# Autodesk Inventor assembly: holder
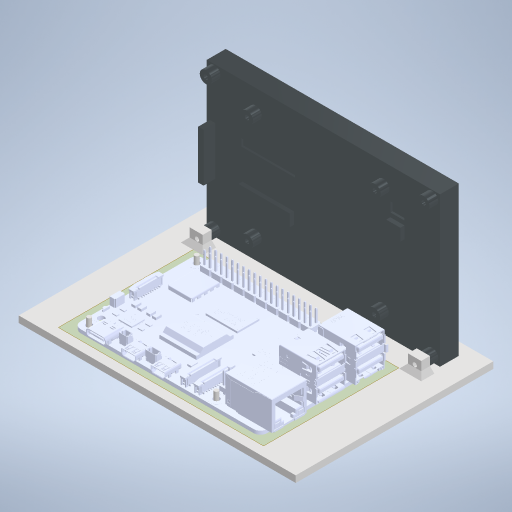
[picture p0: Inventor's stored thumbnail of the model, 512x512]
Saved by Autodesk Inventor 2024.2 (Build 282272000, 272)
## iProperties
Created: 2026-09-12
Part Number: holder
Document SubType Name: Assembly
Designer: katya_notebook
Author: katya_notebook
## Documents named in this file (4)
- D:\dog\fox\construction\podstavkarpi\holder.iam
- D:\dog\fox\construction\podstavkarpi\0329_экран.ipt
- D:\dog\fox\construction\podstavkarpi\RASPBERRY_PI_5\RASPBERRY_PI_5.ipt
- D:\dog\fox\construction\podstavkarpi\деталь крепление.ipt
## Components (3 placed, 3 different names)
1. 0329_экран:1 — Заподлицо:1
2. RASPBERRY_PI_5:1 — Заподлицо:1, Заподлицо:2, Заподлицо:3
3. деталь крепление:1 — Заподлицо:2, Заподлицо:3
## Relationships (3: Flush 3)
- Заподлицо:1 [Flush]: 0329_экран:1 ↔ RASPBERRY_PI_5:1
- Заподлицо:2 [Flush]: RASPBERRY_PI_5:1 ↔ деталь крепление:1
- Заподлицо:3 [Flush]: RASPBERRY_PI_5:1 ↔ деталь крепление:1
